# Autodesk Inventor assembly: base subassembly
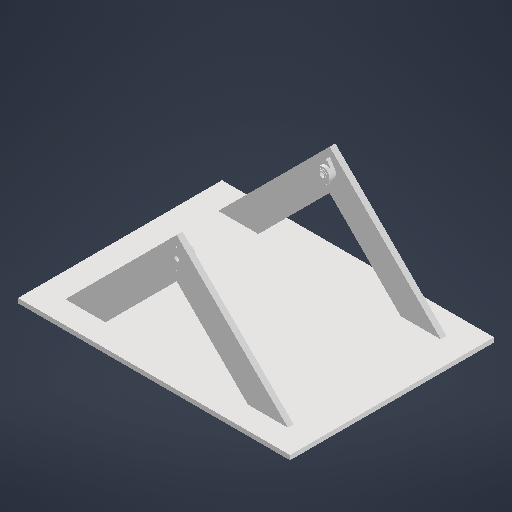
[picture p0: Inventor's stored thumbnail of the model, 512x512]
Saved by Autodesk Inventor 2026.1 (Build 301233000, 233)
## iProperties
Created: 2025-11-11
Part Number: base subassembly
Document SubType Name: Assembly
Designer: shiva
Author: shiva
## Documents named in this file (4)
- D:\assignments\SEM 1\CAM\RPM\bigger version\base assembly\base subassembly.iam
- D:\assignments\SEM 1\CAM\RPM\bigger version\base assembly\base.ipt
- D:\assignments\SEM 1\CAM\RPM\bigger version\base assembly\stand.ipt
- D:\assignments\SEM 1\CAM\RPM\bigger version\bearing.ipt
## Components (5 placed, 3 different names)
1. base:1 — Mate:1, Mate:2, Mate:3, Mate:4, Flush:1, Flush:2
2. stand:1 — Mate:1, Mate:3, Flush:1, Mate:6, Mate:7, Mate:9
3. stand:2 — Mate:2, Mate:4, Flush:2, Mate:5, Mate:8, Mate:10
4. bearing:1 — Mate:5, Mate:8, Mate:10
5. bearing:2 — Mate:6, Mate:7, Mate:9
## Relationships (12: Mate 10, Flush 2)
- Mate:1: base:1 ↔ stand:1
- Mate:2: base:1 ↔ stand:2
- Mate:3 (109.1445 mm): base:1 ↔ stand:1
- Mate:4 (109.1445 mm): base:1 ↔ stand:2
- Flush:1 (100 mm): base:1 ↔ stand:1
- Flush:2 (100 mm): base:1 ↔ stand:2
- Mate:5: stand:2 ↔ bearing:1
- Mate:6: stand:1 ↔ bearing:2
- Mate:7: stand:1 ↔ bearing:2
- Mate:8: stand:2 ↔ bearing:1
- Mate:9: stand:1 ↔ bearing:2
- Mate:10: stand:2 ↔ bearing:1
